# Autodesk Inventor assembly: MM0948AN002_G70_001
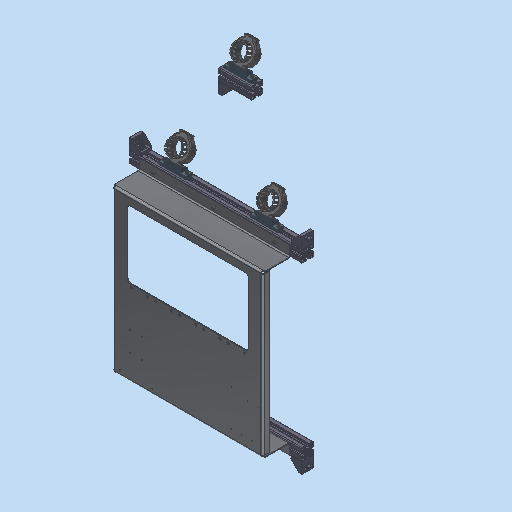
[picture p0: Inventor's stored thumbnail of the model, 512x512]
Saved by Autodesk Inventor 2023.3 (Build 273359000, 359)
## iProperties
Part Number: MM0948AN002_G70_001
Material: Generisch
Description: =<RBPARTNOTITLE2>
Document SubType Name: Assembly
Designer: FH/Wi
Mass: 11081.7 g
Surface Area: 19072.4 cm^2
Volume: 2738.37 cm^3
Density: 4.04681 g/cm^3
Created: 2023-03-23
RBCHANGEDESCRIPTION1: Erstfreigabe
RBCHANGENO1: 00
RBDOCUMENTTYPE: DRF
RBDOCUMENTVERSION: 00
RBDRAWINGMAINSCALE: 1:1
RBDRAWINGMISSINGSPEC: --
RBDRAWINGVOLUME: --
RBDSV1: 0850
RBGBDETAILS: 43274
RBGBEDGESIN1: +0,5
RBGBEDGESIN2: +0,2
RBGBEDGESOUT1: -0,3
RBGBEDGESOUT2: -0,1
RBMATERIAL: =<Material>
RBMATMEETS: --
RBMATNO: =<Part Number>
RBORGUNITRESPONSIBLE1: AnP/TEF1
RBPARTMADEOF: --
RBPARTNO: SIEHE MNR
RBPARTNOTITLE1: connection plate
RBPARTNOTITLE2: Anschlussplatte
RBPARTSAFETYINDICATOR: --
RBSURFACE: --
RBSURFACE2: --
RBZEDGESNORM: ISO13715:2002-06
RBZGENDIMCLASS: m
RBZGENDIMNORM: ISO 2768-1:1989-11
RBZGENGEOCLASS: H
RBZGENGEONORM: ISO 2768-2:1989-11
RBZSURFACENORM: ISO13D2:2002-02
RBZTOLERANCENORM: ISO 14405-1:2010-12
AnP_Kommentar: --
MaxAbmaße: --
AnP_TemplVers: 20190222
AnP_Kategorie: 99
AnP_Material: =<Material>
Author: FH/Wi
Keywords: =<RBPARTMADEOF>
Comments: =<RBSURFACE2>
Revision Number: 01
## Documents named in this file (13)
- C:\Users\rea9an\Documents\Inventor\TCAI2412_te1910_EM\AS00000933.iam
- C:\Users\rea9an\Documents\Inventor\TCAI2412_te1910_EM\PT00004326.ipt
- C:\Users\rea9an\Documents\Inventor\TCAI2412_te1910_EM\PT00004887.ipt
- C:\Users\rea9an\Documents\Inventor\TCAI2412_te1910_EM\PT00004538.ipt
- C:\Users\rea9an\Documents\Inventor\TCAI2412_te1910_EM\PT00004888.ipt
- C:\Users\rea9an\Documents\Inventor\TCAI2412_te1910_EM\PT00004448.ipt
- C:\Users\rea9an\Documents\Inventor\TCAI2412_te1910_EM\PT00004449.ipt
- C:\Users\rea9an\Documents\Inventor\TCAI2412_te1910_EM\PT00004300.ipt
- C:\Users\rea9an\Documents\Inventor\TCAI2412_te1910_EM\PT00004581.ipt
- C:\Users\rea9an\Documents\Inventor\TCAI2412_te1910_EM\PT00004582.ipt
- C:\Users\rea9an\Documents\Inventor\TCAI2412_te1910_EM\PT00004310.ipt
- C:\Users\rea9an\Documents\Inventor\TCAI2412_te1910_EM\PT00004337.ipt
- C:\Users\rea9an\Documents\Inventor\TCAI2412_te1910_EM\PT00004886.ipt
## Components (51 placed, 12 different names)
1. PT00004326:2 — Fluchtend:46, Fluchtend:47, Fluchtend:57, Fluchtend:61, Passend:144
2. PT00004300:4
3. PT00004300:5
4. PT00004581:1 — Fluchtend:55, Fluchtend:57, Passend:144, Fluchtend:69, Einfügen:105, Einfügen:106, Einfügen:107, Einfügen:108, Einfügen:109, Einfügen:110
5. PT00004582:1 — Passend:140, Fluchtend:56, Passend:141, Passend:142, Einfügen:69, Fluchtend:62, Einfügen:89, Einfügen:90, Fluchtend:68
6. PT00004538:4 — Passend:141, Passend:142, Einfügen:69, Einfügen:70, Einfügen:71, Einfügen:72
7. PT00004887:10 — Einfügen:70
8. PT00004887:11 — Einfügen:71
9. PT00004887:12 — Einfügen:72
10. PT00004582:2 — Passend:147, Fluchtend:62, Einfügen:81, Einfügen:82, Fluchtend:67
11. PT00004538:5
12. PT00004887:13
13. PT00004887:14
14. PT00004887:15
15. PT00004888:5 — Einfügen:81, Einfügen:84
16. PT00004888:6 — Einfügen:82, Einfügen:83
17. PT00004310:1 — Einfügen:83
18. PT00004310:2
19. PT00004310:3 — Einfügen:84
20. PT00004888:7 — Einfügen:89
21. PT00004310:4
22. PT00004888:8 — Einfügen:90
23. PT00004310:5
24. PT00004582:4 — Fluchtend:66
25. PT00004538:7
26. PT00004887:19
27. PT00004887:20
28. PT00004887:21
29. PT00004888:11
30. PT00004888:12
31. PT00004310:8
32. PT00004310:9
33. PT00004886:1 — Einfügen:108, Einfügen:111
34. PT00004886:2 — Einfügen:109, Einfügen:112
35. PT00004886:3 — Einfügen:110, Einfügen:113
36. PT00004886:4 — Einfügen:105, Einfügen:114
37. PT00004886:5 — Einfügen:106, Einfügen:115
38. PT00004886:6 — Einfügen:107, Einfügen:116
39. PT00004310:10 — Einfügen:111
40. PT00004310:11 — Einfügen:112
41. PT00004310:12 — Einfügen:113
42. PT00004310:13 — Einfügen:114
43. PT00004310:14 — Einfügen:115
44. PT00004310:15 — Einfügen:116
45. PT00004448:1
46. PT00004449:1
47. PT00004300:2 — Passend:129, Fluchtend:41, Fluchtend:42
48. PT00004300:1 — Passend:15, Passend:127, Fluchtend:38
49. PT00004326:1 — Passend:1, Fluchtend:1, Passend:15, Passend:127, Fluchtend:38, Passend:129, Fluchtend:41, Fluchtend:42, Fluchtend:46, Fluchtend:47, Passend:140, Fluchtend:56, Passend:147, Fluchtend:67, Fluchtend:68, Fluchtend:69
50. PT00004337:1 — Fluchtend:66
51. PT00004300:3
## Relationships (78: Insert 36, Flush 22, Mate 20)
- Passend:1 [Mate] (320 mm): PT00004326:1
- Fluchtend:1 [Flush] (-352.5 mm): PT00004326:1
- Passend:15 [Mate]: PT00004300:1 ↔ PT00004326:1
- [Mate] (287 mm): PT00004326:1 ↔ PT00004337:1
- Passend:127 [Mate]: PT00004300:1 ↔ PT00004326:1
- Fluchtend:38 [Flush] (1 mm): PT00004300:1 ↔ PT00004326:1
- [Mate]: PT00004337:1 ↔ PT00004300:3
- [Flush]: PT00004337:1 ↔ PT00004300:3
- [Flush] (1 mm): PT00004337:1 ↔ PT00004300:3
- Passend:129 [Mate]: PT00004300:2 ↔ PT00004326:1
- Fluchtend:41 [Flush]: PT00004300:2 ↔ PT00004326:1
- Fluchtend:42 [Flush] (1 mm): PT00004300:2 ↔ PT00004326:1
- [Mate]: PT00004326:2 ↔ PT00004300:4
- [Mate]: PT00004326:2 ↔ PT00004300:4
- [Flush] (1 mm): PT00004326:2 ↔ PT00004300:4
- [Mate]: PT00004326:2 ↔ PT00004300:5
- [Flush]: PT00004326:2 ↔ PT00004300:5
- [Flush] (1 mm): PT00004326:2 ↔ PT00004300:5
- Fluchtend:46 [Flush]: PT00004326:2 ↔ PT00004326:1
- Fluchtend:47 [Flush]: PT00004326:2 ↔ PT00004326:1
- Fluchtend:55 [Flush]: PT00004581:1
- Passend:140 [Mate]: PT00004582:1 ↔ PT00004326:1
- Fluchtend:56 [Flush] (10 mm): PT00004582:1 ↔ PT00004326:1
- Passend:141 [Mate]: PT00004582:1 ↔ PT00004538:4
- Passend:142 [Mate]: PT00004582:1 ↔ PT00004538:4
- Fluchtend:57 [Flush] (3 mm): PT00004326:2 ↔ PT00004581:1
- [Mate] (2048 mm): PT00004337:1
- Fluchtend:61 [Flush] (-1332.5 mm): PT00004326:2
- Passend:144 [Mate]: PT00004326:2 ↔ PT00004581:1
- Einfügen:69 [Insert]: PT00004582:1 ↔ PT00004538:4
- Einfügen:70 [Insert]: PT00004538:4 ↔ PT00004887:10
- Einfügen:71 [Insert]: PT00004538:4 ↔ PT00004887:11
- Einfügen:72 [Insert]: PT00004538:4 ↔ PT00004887:12
- [Mate]: PT00004582:2 ↔ PT00004538:5
- [Mate]: PT00004582:2 ↔ PT00004538:5
- [Insert]: PT00004582:2 ↔ PT00004538:5
- [Insert]: PT00004538:5 ↔ PT00004887:13
- [Insert]: PT00004538:5 ↔ PT00004887:14
- [Insert]: PT00004538:5 ↔ PT00004887:15
- Passend:147 [Mate]: PT00004582:2 ↔ PT00004326:1
- Fluchtend:62 [Flush]: PT00004582:1 ↔ PT00004582:2
- Einfügen:81 [Insert]: PT00004582:2 ↔ PT00004888:5
- Einfügen:82 [Insert]: PT00004582:2 ↔ PT00004888:6
- Einfügen:83 [Insert] (13 mm): PT00004888:6 ↔ PT00004310:1
- Einfügen:84 [Insert] (13 mm): PT00004888:5 ↔ PT00004310:3
- [Insert] (13 mm): PT00004888:7 ↔ PT00004310:4
- [Insert] (13 mm): PT00004888:8 ↔ PT00004310:5
- Einfügen:89 [Insert]: PT00004582:1 ↔ PT00004888:7
- Einfügen:90 [Insert]: PT00004582:1 ↔ PT00004888:8
- [Mate]: PT00004582:4 ↔ PT00004538:7
- [Mate]: PT00004582:4 ↔ PT00004538:7
- [Insert]: PT00004582:4 ↔ PT00004538:7
- [Insert]: PT00004538:7 ↔ PT00004887:19
- [Insert]: PT00004538:7 ↔ PT00004887:20
- [Insert]: PT00004538:7 ↔ PT00004887:21
- [Insert]: PT00004582:4 ↔ PT00004888:11
- [Insert]: PT00004582:4 ↔ PT00004888:12
- [Insert] (13 mm): PT00004888:12 ↔ PT00004310:8
- [Insert] (13 mm): PT00004888:11 ↔ PT00004310:9
- [Mate]: PT00004582:4 ↔ PT00004337:1
- [Flush] (10 mm): PT00004582:4 ↔ PT00004337:1
- [Flush]: PT00004326:1 ↔ PT00004337:1
- Fluchtend:66 [Flush] (10 mm): PT00004582:4 ↔ PT00004337:1
- Fluchtend:67 [Flush] (100 mm): PT00004582:2 ↔ PT00004326:1
- Fluchtend:68 [Flush] (100 mm): PT00004582:1 ↔ PT00004326:1
- Fluchtend:69 [Flush] (3 mm): PT00004581:1 ↔ PT00004326:1
- Einfügen:105 [Insert]: PT00004581:1 ↔ PT00004886:4
- Einfügen:106 [Insert]: PT00004581:1 ↔ PT00004886:5
- Einfügen:107 [Insert]: PT00004581:1 ↔ PT00004886:6
- Einfügen:108 [Insert]: PT00004581:1 ↔ PT00004886:1
- Einfügen:109 [Insert]: PT00004581:1 ↔ PT00004886:2
- Einfügen:110 [Insert]: PT00004581:1 ↔ PT00004886:3
- Einfügen:111 [Insert] (6 mm): PT00004886:1 ↔ PT00004310:10
- Einfügen:112 [Insert] (6 mm): PT00004886:2 ↔ PT00004310:11
- Einfügen:113 [Insert] (6 mm): PT00004886:3 ↔ PT00004310:12
- Einfügen:114 [Insert] (6 mm): PT00004886:4 ↔ PT00004310:13
- Einfügen:115 [Insert] (6 mm): PT00004886:5 ↔ PT00004310:14
- Einfügen:116 [Insert] (6 mm): PT00004886:6 ↔ PT00004310:15
## Named parameters: d326_d318 = 0 mm, d327_d319 = 1 mm, d328_d323 = 0 mm, d329_d324 = 0 mm, d330_d325 = 1 mm, d331_d36 = 0 mm, d367_d354 = 0 mm, d368_d355 = 0 mm, d369_d363 = 0 mm, d370_d364 = 0 mm, d371_d365 = 0 mm, d372_d366 = 0 mm, d387_d386 = 13 mm, d388_d386 = 13 mm, d395_d367_d354 = 0 mm, d396_d368_d355 = 0 mm, d397_d369_d363 = 0 mm, d398_d370_d364 = 0 mm, d399_d371_d365 = 0 mm, d400_d372_d366 = 0 mm, d401_d383 = 0 mm, d402_d384 = 0 mm, d403_d385 = 13 mm, d404_d386 = 13 mm
